# Autodesk Inventor assembly: Final Design v2
(part 2 of 2)
- BR_Constraint_Mate_BC_492263609261916_1_2 [Mate]: 3842993710_STRUT PROFILE 30x45_h150_260914152035980:1 ↔ 3842523530_GUSSET 30_30_h150_260919162636492
## Named parameters: BR_WP1_BR_WP2_Length_090614421468726 = 850 mm, BR_WP1_BR_WP3_Length_090614421473226 = 350 mm, BR_WP2_BR_WP4_Length_090614421478226 = 600 mm, BR_WP4_BR_WP5_Length_090614421482026 = 850 mm, BR_WP5_BR_WP6_Length_090614421489026 = 350 mm, BR_WP7_BR_WP8_Length_090614421494126 = 600 mm, BR_WP8_BR_WP9_Length_090614421498426 = 300 mm, BR_WP9_BR_WP10_Length_090614431403026 = 300 mm, BR_WP9_BR_WP11_Length_090614431407326 = 300 mm, BR_WP10_BR_WP12_Length_090614431411326 = 550 mm, BR_WP11_BR_WP13_Length_090614431415426 = 550 mm, BR_WP13_BR_WP1_Length_090614431418526 = 599.70922 mm, BR_WP12_BR_WP5_Length_090614431422826 = 600.00427 mm, BR_WP5_BR_WP14_Length_090614431427426 = 350 mm, BR_WP14_BR_WP6_Length_090614431430626 = 494.97475 mm, BR_WP1_BR_WP15_Length_090614431435326 = 350 mm, BR_WP15_BR_WP3_Length_090614431438826 = 494.97475 mm, BR_WP12_BR_WP16_Length_090614431443426 = 100 mm, BR_WP13_BR_WP17_Length_090614431448026 = 100 mm, BR_WP17_BR_WP18_Length_090614431453226 = 80 mm, BR_WP16_BR_WP19_Length_090614431457626 = 80 mm, BR_WP8_BR_WP11_Length_094914001415726 = 416.08607 mm, BR_WP10_BR_WP8_Length_094914001436626 = 429.45547 mm, BR_WP10_BR_WP4_Length_094914001457926 = 670.79292 mm, BR_WP11_BR_WP2_Length_094914001478426 = 667.78486 mm, BR_WP2_BR_WP20_Length_094914011406026 = 100 mm, BR_WP2_BR_WP21_Length_094914011434126 = 100 mm, BR_WP21_BR_WP20_Length_094914011457326 = 141.42136 mm, BR_WP4_BR_WP22_Length_094914011484826 = 100 mm, BR_WP4_BR_WP23_Length_094914021411526 = 100 mm, BR_WP23_BR_WP22_Length_094914021435126 = 141.42136 mm, BR_WP13_BR_WP24_Length_090815361471526 = 30 mm, BR_WP12_BR_WP25_Length_090815361491226 = 30 mm, BR_WP24_BR_WP26_Length_090815371411926 = 275 mm, BR_WP24_BR_WP27_Length_090815371432926 = 275 mm, BR_WP25_BR_WP28_Length_090815371454326 = 275 mm, BR_WP25_BR_WP29_Length_090815371477426 = 275 mm, BR_WP27_BR_WP26_Length_091915441444126 = 549.99999 mm, BR_WP29_BR_WP30_Length_091915441473026 = 550 mm, BR_WP26_BR_WP31_Length_092115591427826 = 80 mm, BR_WP30_BR_WP32_Length_092115591455826 = 80 mm, BR_WP4_BR_WP33_Length_095612201518526 = 600 mm, BR_WP2_BR_WP34_Length_095612201576026 = 600 mm, BR_WP33_BR_WP34_Length_095612211530326 = 600 mm, BR_WP33_BR_WP2_Length_095612211588426 = 848.52814 mm, BR_WP33_BR_WP10_Length_095612221547926 = 299.93003 mm, BR_WP34_BR_WP11_Length_095612231512826 = 293.80937 mm, BR_WP35_BR_WP4_Length_095612231592526 = 848.52814 mm, BR_WP36_BR_WP2_Length_095612241576626 = 848.52814 mm
